# Autodesk Inventor assembly: BG004_bensen22_26
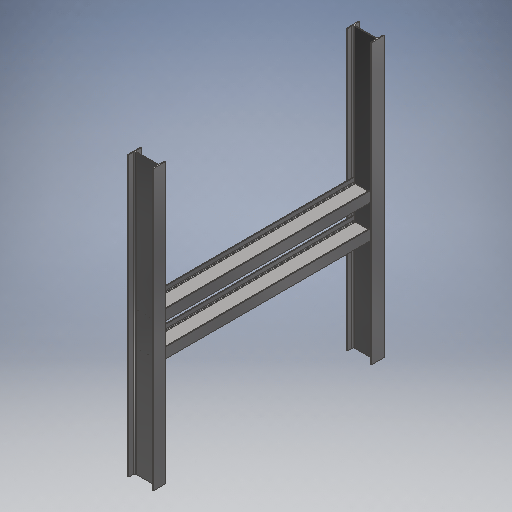
[picture p0: Inventor's stored thumbnail of the model, 512x512]
Saved by Autodesk Inventor 2025.3 (Build 293356000, 356)
## iProperties
Company: HTBLA Kaindorf
RuleStatus: InUse
Created: 2026-08-13
Part Number: BG004_bensen22_26
Project: Biegeroboter
Material: Generisch
Description: deckenkonstruktion_gesamt_v1
Document SubType Name: Assembly
Designer: bensen22
Mass: 339176 g
Surface Area: 102505 cm^2
Volume: 43207.1 cm^3
Density: 7.85 g/cm^3
AfterDocNew0: iProperties-Editor_aufrufen
Author: sebas
Keywords: 2026
## Documents named in this file (3)
- C:\Users\trist\Desktop\Schule\diplomarbeit_dateien\Mechanik\Biegekopf\Deckenkonstruktion\BG004_bensen22_26_Biegeroboter_deckenkonstruktion_gesamt_v1.iam
- C:\Users\trist\Desktop\Schule\diplomarbeit_dateien\Mechanik\Biegekopf\Deckenkonstruktion\DIN 1025 - IPE 270-3000.ipt
- C:\Users\trist\Desktop\Schule\diplomarbeit_dateien\Mechanik\Biegekopf\Deckenkonstruktion\DIN 1025 - IPE 220-2343,4.ipt
## Components (4 placed, 2 different names)
1. DIN 1025 - IPE 270-3000:1 — Fluchtend:1, Fluchtend:2, Passend:1, Fluchtend:3
2. DIN 1025 - IPE 270-3000:2 — Fluchtend:1, Fluchtend:2, Passend:1, Passend:2, Passend:3, Passend:4, Passend:5
3. DIN 1025 - IPE 220-2343,4:1 — Passend:2, Passend:5, Passend:6
4. DIN 1025 - IPE 220-2343,4:2 — Passend:3, Passend:4, Passend:6, Fluchtend:3
## Relationships (9: Mate 6, Flush 3)
- Fluchtend:1 [Flush]: DIN 1025 - IPE 270-3000:1 ↔ DIN 1025 - IPE 270-3000:2
- Fluchtend:2 [Flush]: DIN 1025 - IPE 270-3000:1 ↔ DIN 1025 - IPE 270-3000:2
- Passend:1 [Mate] (2343.4 mm): DIN 1025 - IPE 270-3000:1 ↔ DIN 1025 - IPE 270-3000:2
- Passend:2 [Mate]: DIN 1025 - IPE 270-3000:2 ↔ DIN 1025 - IPE 220-2343,4:1
- Passend:3 [Mate]: DIN 1025 - IPE 270-3000:2 ↔ DIN 1025 - IPE 220-2343,4:2
- Passend:4 [Mate]: DIN 1025 - IPE 270-3000:2 ↔ DIN 1025 - IPE 220-2343,4:2
- Passend:5 [Mate]: DIN 1025 - IPE 270-3000:2 ↔ DIN 1025 - IPE 220-2343,4:1
- Passend:6 [Mate] (350 mm): DIN 1025 - IPE 220-2343,4:1 ↔ DIN 1025 - IPE 220-2343,4:2
- Fluchtend:3 [Flush] (1411.175 mm): DIN 1025 - IPE 270-3000:1 ↔ DIN 1025 - IPE 220-2343,4:2
